# Autodesk Inventor assembly: Rack and Pinion
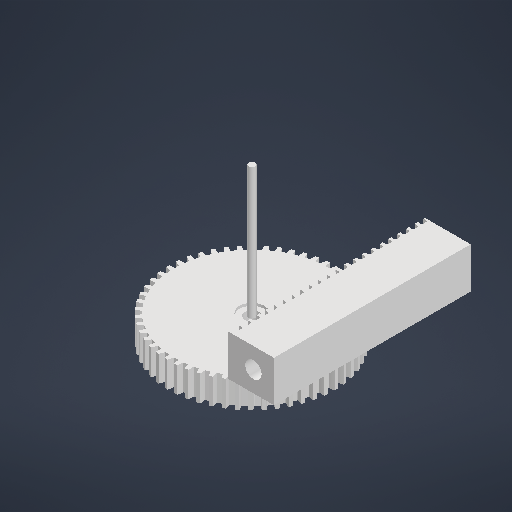
[picture p0: Inventor's stored thumbnail of the model, 512x512]
Saved by Autodesk Inventor 2027 (Build 310192060, 192F)
## iProperties
Created: 2026-10-24
Part Number: Rack and Pinion
Document SubType Name: Assembly
Designer: troop
Author: troop
## Documents named in this file (4)
- C:\Users\troop\OneDrive\Documents\Inventor\SpaceX Rocket\Rack and Pinion.iam
- C:\Users\troop\OneDrive\Documents\Inventor\SpaceX Rocket\Servo Wheel.ipt
- C:\Users\troop\OneDrive\Documents\Inventor\SpaceX Rocket\Servo gear pin.ipt
- C:\Users\troop\OneDrive\Documents\Inventor\SpaceX Rocket\pin.ipt
## Components (3 placed, 3 different names)
1. Servo Wheel:1 — Rotation/Translation:1, Insert:1
2. pin:1 — Rotation/Translation:1, Insert:1
3. Servo gear pin:1
## Relationships (2: RelateRotateTranslate 1, Insert 1)
- Rotation/Translation:1 [RelateRotateTranslate] (3.9878 mm): Servo Wheel:1 ↔ pin:1
- Insert:1: Servo Wheel:1 ↔ pin:1
